# Autodesk Inventor assembly: dulap_chiuveta
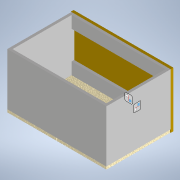
[picture p0: Inventor's stored thumbnail of the model, 180x180]
Saved by Autodesk Inventor 2022.6 (Build 266554000, 554)
## iProperties
Created: 2025-08-04
Part Number: dulap_chiuveta
Document SubType Name: Assembly
Designer: Dragos Macovei
Author: Dragos Macovei
## Documents named in this file (6)
- C:\Users\Dragos Macovei\Documents\Inventor_3d_parts\Tancabesti_comanda_pal\dulap_chiuveta.iam
- C:\Users\Dragos Macovei\Documents\Inventor_3d_parts\Tancabesti_comanda_pal\blat_chiuveta.ipt
- C:\Users\Dragos Macovei\Documents\Inventor_3d_parts\Tancabesti_comanda_pal\lateral_chiuveta.ipt
- C:\Users\Dragos Macovei\Documents\Inventor_3d_parts\Tancabesti_comanda_pal\intaritura_blat.ipt
- C:\Users\Dragos Macovei\Documents\Inventor_3d_parts\Tancabesti_comanda_pal\usa_dulap_baie.ipt
- C:\Users\Dragos Macovei\Documents\Inventor_3d_parts\Tancabesti_comanda_pal\fund_chiuveta.ipt
## Components (8 placed, 5 different names)
1. blat_chiuveta:1 — Mate:2, Flush:3, Mate:3, Mate:4, Flush:7, Mate:12, Flush:8, Flush:10
2. lateral_chiuveta:1 — Mate:11, Mate:12, Flush:8, Mate:17, Flush:18, Mate:18
3. lateral_chiuveta:2 — Mate:2, Flush:3, Mate:9, Flush:7, Mate:10, Flush:9, Flush:10, Flush:11, Mate:16, Flush:16, Flush:19, Flush:20
4. intaritura_blat:1 — Mate:3, Mate:9, Flush:11
5. intaritura_blat:2 — Mate:4, Mate:10, Mate:11, Flush:9
6. usa_dulap_baie:1 — Mate:16, Flush:16
7. usa_dulap_baie:2 — Mate:17, Flush:18
8. fund_chiuveta:1 — Mate:18, Flush:19, Flush:20
## Relationships (20: Mate 10, Flush 10)
- Mate:2: blat_chiuveta:1 ↔ lateral_chiuveta:2
- Flush:3: blat_chiuveta:1 ↔ lateral_chiuveta:2
- Mate:3: blat_chiuveta:1 ↔ intaritura_blat:1
- Mate:4: blat_chiuveta:1 ↔ intaritura_blat:2
- Mate:9: lateral_chiuveta:2 ↔ intaritura_blat:1
- Flush:7: blat_chiuveta:1 ↔ lateral_chiuveta:2
- Mate:10: lateral_chiuveta:2 ↔ intaritura_blat:2
- Mate:11: lateral_chiuveta:1 ↔ intaritura_blat:2
- Mate:12: blat_chiuveta:1 ↔ lateral_chiuveta:1
- Flush:8: blat_chiuveta:1 ↔ lateral_chiuveta:1
- Flush:9: lateral_chiuveta:2 ↔ intaritura_blat:2
- Flush:10: blat_chiuveta:1 ↔ lateral_chiuveta:2
- Flush:11: lateral_chiuveta:2 ↔ intaritura_blat:1
- Mate:16: lateral_chiuveta:2 ↔ usa_dulap_baie:1
- Flush:16: lateral_chiuveta:2 ↔ usa_dulap_baie:1
- Mate:17: lateral_chiuveta:1 ↔ usa_dulap_baie:2
- Flush:18: lateral_chiuveta:1 ↔ usa_dulap_baie:2
- Mate:18: lateral_chiuveta:1 ↔ fund_chiuveta:1
- Flush:19: lateral_chiuveta:2 ↔ fund_chiuveta:1
- Flush:20: lateral_chiuveta:2 ↔ fund_chiuveta:1
